# Autodesk Inventor assembly: Ebatterie
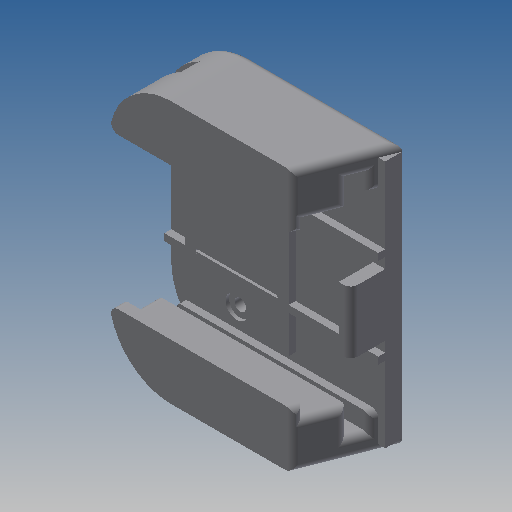
[picture p0: Inventor's stored thumbnail of the model, 512x512]
Saved by Autodesk Inventor 2025.3 (Build 293356000, 356)
## iProperties
Created: 2025-06-22
Part Number: Ebatterie
Project: Nom Projet
Description: Ens. Nom Ensemble
Document SubType Name: Assembly
Designer: matpo
Author: matpo
## Documents named in this file (3)
- C:\Users\matpo\OneDrive - HESSO\P2511_RVEZ\01_Robot\0101_CAO\5_Pompe\Ebatterie.iam
- C:\Users\matpo\OneDrive - HESSO\P2511_RVEZ\01_Robot\0101_CAO\5_Pompe\chargeur_pompe.ipt
- C:\Users\matpo\OneDrive - HESSO\P2511_RVEZ\01_Robot\0101_CAO\5_Pompe\supportchargeur.ipt
## Components (2 placed, 2 different names)
1. chargeur_pompe:1 — Affleurement:1
2. supportchargeur:1 — Affleurement:1
## Relationships (1: Flush 1)
- Affleurement:1 [Flush]: chargeur_pompe:1 ↔ supportchargeur:1
